# Autodesk Inventor assembly: gate_or-a
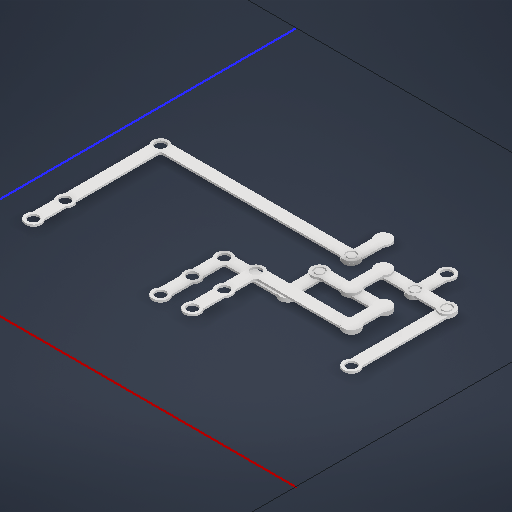
[picture p0: Inventor's stored thumbnail of the model, 512x512]
Saved by Autodesk Inventor 2025.4 (Build 294407000, 407)
## iProperties
Created: 2026-10-14
Part Number: gate_or-a
Document SubType Name: Assembly
Designer: User
Author: User
## Documents named in this file (13)
- G:\projects\primary\mechanical-computer\mechanics\gates\gate_or-a.iam
- G:\projects\primary\mechanical-computer\mechanics\gates\decoder.iam
- G:\projects\primary\mechanical-computer\mechanics\links\link\link-8-2pin.ipt
- G:\projects\primary\mechanical-computer\mechanics\links\link.ipt
- G:\projects\primary\mechanical-computer\mechanics\links\link\link-8-2pin-same.ipt
- G:\projects\primary\mechanical-computer\mechanics\links\link-split\link-split-8ab.ipt
- G:\projects\primary\mechanical-computer\mechanics\links\link-split.ipt
- G:\projects\primary\mechanical-computer\mechanics\links\link\link-8-1pin.ipt
- G:\projects\primary\mechanical-computer\mechanics\links\link-1-turn-rigid\link-1-turn-rigid-6(_AS)8w-3(_AS)8l.ipt
- G:\projects\primary\mechanical-computer\mechanics\links\link-1-turn-rigid.ipt
- G:\projects\primary\mechanical-computer\mechanics\links\link-1-turn-rigid\link-1-turn-rigid-2(_AS)8w-8l.ipt
- G:\projects\primary\mechanical-computer\mechanics\links\link-1-turn-rigid\link-1-turn-rigid-3(_AS)8w-8l.ipt
- G:\projects\primary\mechanical-computer\mechanics\links\link\link-8(_AS)3-1pin.ipt
## Components (12 placed, 9 different names)
1. decoder:1 [sub-assembly] — Mate:5, Mate:6, Mate:8, Mate:9, Mate:12, Cylindrical:8, Cylindrical:9, Mate:16, Mate:17
2. link-8-2pin-same:2 — Angle:4
3. link-split-8ab:1 — Cylindrical:7, Mate:11, Cylindrical:11, Angle:4
4. link-split-8ab:2 — Mate:15, Cylindrical:12
5. link-8-1pin:3
6. link-1-turn-rigid-6(_AS)8w-3(_AS)8l:1 — Mate:5, Mate:6, Cylindrical:5, Mate:7, Mate:17, Angle:2
7. link-8-2pin:4 — Cylindrical:5, Mate:7, Angle:2
8. link-1-turn-rigid-2(_AS)8w-8l:2 — Mate:8, Mate:9, Cylindrical:6, Mate:10, Mate:12
9. link-8-2pin:5 — Cylindrical:6, Cylindrical:7, Mate:10, Mate:11, Mate:13
10. link-1-turn-rigid-3(_AS)8w-8l:3 — Cylindrical:8, Cylindrical:9, Mate:13, Cylindrical:10, Mate:14, Angle:3
11. link-8-2pin-same:6 — Cylindrical:10, Mate:14, Cylindrical:11, Angle:3
12. link-8(_AS)3-1pin:7 — Mate:15, Cylindrical:12, Mate:16
## Relationships (31: Mate 16, CylindricalJoint 11, Angle 4)
- [Mate]: link-split-8ab:2 ↔ link-8-1pin:3
- [CylindricalJoint]: link-split-8ab:2 ↔ link-8-1pin:3
- [Mate]: link-8-2pin-same:2 ↔ link-split-8ab:2
- [CylindricalJoint]: link-8-2pin-same:2 ↔ link-split-8ab:2
- [CylindricalJoint]: link-8-2pin-same:2 ↔ link-split-8ab:1
- [Mate]: link-8-2pin-same:2 ↔ link-split-8ab:1
- [Angle] (90 deg): link-split-8ab:2 ↔ link-8-1pin:3
- Mate:5: decoder:1 ↔ link-1-turn-rigid-6(_AS)8w-3(_AS)8l:1
- Mate:6: decoder:1 ↔ link-1-turn-rigid-6(_AS)8w-3(_AS)8l:1
- Cylindrical:5: link-1-turn-rigid-6(_AS)8w-3(_AS)8l:1 ↔ link-8-2pin:4
- Mate:7: link-1-turn-rigid-6(_AS)8w-3(_AS)8l:1 ↔ link-8-2pin:4
- Mate:8: decoder:1 ↔ link-1-turn-rigid-2(_AS)8w-8l:2
- Mate:9: decoder:1 ↔ link-1-turn-rigid-2(_AS)8w-8l:2
- Cylindrical:6: link-1-turn-rigid-2(_AS)8w-8l:2 ↔ link-8-2pin:5
- Cylindrical:7: link-split-8ab:1 ↔ link-8-2pin:5
- Mate:10: link-1-turn-rigid-2(_AS)8w-8l:2 ↔ link-8-2pin:5
- Mate:11: link-split-8ab:1 ↔ link-8-2pin:5
- Mate:12: decoder:1 ↔ link-1-turn-rigid-2(_AS)8w-8l:2
- Cylindrical:8: decoder:1 ↔ link-1-turn-rigid-3(_AS)8w-8l:3
- Cylindrical:9: decoder:1 ↔ link-1-turn-rigid-3(_AS)8w-8l:3
- Mate:13: link-8-2pin:5 ↔ link-1-turn-rigid-3(_AS)8w-8l:3
- Cylindrical:10: link-1-turn-rigid-3(_AS)8w-8l:3 ↔ link-8-2pin-same:6
- Mate:14: link-1-turn-rigid-3(_AS)8w-8l:3 ↔ link-8-2pin-same:6
- Cylindrical:11: link-split-8ab:1 ↔ link-8-2pin-same:6
- Mate:15: link-split-8ab:2 ↔ link-8(_AS)3-1pin:7
- Cylindrical:12: link-split-8ab:2 ↔ link-8(_AS)3-1pin:7
- Mate:16: decoder:1 ↔ link-8(_AS)3-1pin:7
- Mate:17 (0.5 mm): decoder:1 ↔ link-1-turn-rigid-6(_AS)8w-3(_AS)8l:1
- Angle:2 (-90 deg): link-1-turn-rigid-6(_AS)8w-3(_AS)8l:1 ↔ link-8-2pin:4
- Angle:3 (-90 deg): link-1-turn-rigid-3(_AS)8w-8l:3 ↔ link-8-2pin-same:6
- Angle:4 (-90 deg): link-8-2pin-same:2 ↔ link-split-8ab:1
